# Autodesk Inventor assembly: Ensamblaje1
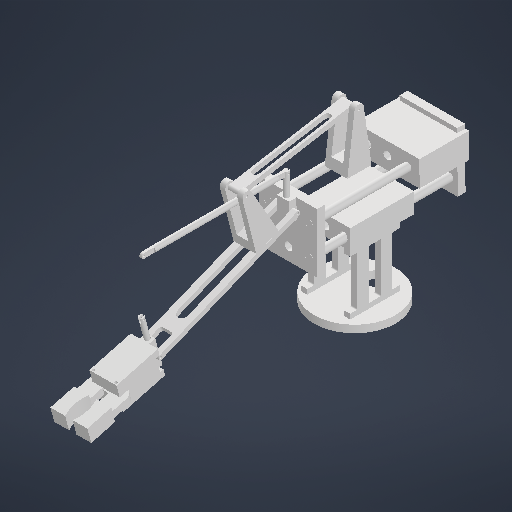
[picture p0: Inventor's stored thumbnail of the model, 512x512]
Saved by Autodesk Inventor 2027.1 (Build 311270010, 270A)
## iProperties
Created: 2026-11-02
Part Number: Ensamblaje1
Document SubType Name: Assembly
Designer: MANGEL
Author: MANGEL
## Documents named in this file (16)
- C:\Users\MANGEL\Desktop\Brazo 4GL\Ensamblaje1.iam
- C:\Users\MANGEL\Desktop\Brazo 4GL\baseCorredera.ipt
- C:\Users\MANGEL\Desktop\Brazo 4GL\BaseRodilloX.ipt
- C:\Users\MANGEL\Desktop\Brazo 4GL\soporteCorrederas.ipt
- C:\Users\MANGEL\Desktop\Brazo 4GL\barraDesliz.ipt
- C:\Users\MANGEL\Desktop\Brazo 4GL\BaseRodilloY.ipt
- C:\Users\MANGEL\Desktop\Brazo 4GL\Pieza14.ipt
- C:\Users\MANGEL\Desktop\Brazo 4GL\soporteBarrasBrazo.ipt
- C:\Users\MANGEL\Desktop\Brazo 4GL\barraBrazo1.ipt
- C:\Users\MANGEL\Desktop\Brazo 4GL\barraBrazo2.ipt
- C:\Users\MANGEL\Desktop\Brazo 4GL\trasePinza.ipt
- C:\Users\MANGEL\Desktop\Brazo 4GL\soportePinza.ipt
- C:\Users\MANGEL\Desktop\Brazo 4GL\pinza.ipt
- C:\Users\MANGEL\Desktop\Brazo 4GL\soporteRodillo.ipt
- C:\Users\MANGEL\Desktop\Brazo 4GL\barillaBrazo.ipt
- C:\Users\MANGEL\Desktop\Brazo 4GL\baseBrazo.ipt
## Components (23 placed, 15 different names)
1. baseCorredera:1 — Nivelación:1, Nivelación:2, Coincidencia:1, Nivelación:5
2. baseCorredera:2 — Nivelación:1, Nivelación:2, Nivelación:3, Nivelación:4
3. BaseRodilloX:1 — Coincidencia:1, Nivelación:3, Nivelación:4, Nivelación:5
4. soporteCorrederas:1 — Insertar:3, Insertar:8, Coincidencia:8
5. soporteCorrederas:2 — Insertar:1, Insertar:4, Insertar:5, Insertar:6, Coincidencia:2, Nivelación:6, Coincidencia:8
6. barraDesliz:1 — Insertar:6, Insertar:8
7. barraDesliz:2 — Insertar:5
8. barraDesliz:3 — Insertar:1, Insertar:3
9. barraDesliz:4 — Insertar:4
10. BaseRodilloY:1 — Coincidencia:3
11. Pieza14:1 — Coincidencia:2, Nivelación:6, Insertar:9
12. soporteBarrasBrazo:1 — Coincidencia:3
13. barraBrazo1:1 — Insertar:9, Coincidencia:4, Nivelación:8, Coincidencia:5, Insertar:11
14. soporteBarrasBrazo:2 — Coincidencia:4, Nivelación:8, Coincidencia:5, Insertar:10
15. barraBrazo2:1 — Insertar:10
16. trasePinza:1 — Insertar:11
17. soportePinza:1
18. pinza:1
19. pinza:2
20. soporteRodillo:1
21. soporteRodillo:2
22. barillaBrazo:1
23. baseBrazo:1
## Relationships (22: Insert 9, Flush 7, Mate 6)
- Nivelación:1 [Flush]: baseCorredera:1 ↔ baseCorredera:2
- Nivelación:2 [Flush]: baseCorredera:1 ↔ baseCorredera:2
- Coincidencia:1 [Mate]: baseCorredera:1 ↔ BaseRodilloX:1
- Nivelación:3 [Flush]: baseCorredera:2 ↔ BaseRodilloX:1
- Nivelación:4 [Flush]: baseCorredera:2 ↔ BaseRodilloX:1
- Nivelación:5 [Flush]: baseCorredera:1 ↔ BaseRodilloX:1
- Insertar:1: soporteCorrederas:2 ↔ barraDesliz:3
- Insertar:3: soporteCorrederas:1 ↔ barraDesliz:3
- Insertar:4: soporteCorrederas:2 ↔ barraDesliz:4
- Insertar:5: soporteCorrederas:2 ↔ barraDesliz:2
- Insertar:6: soporteCorrederas:2 ↔ barraDesliz:1
- Insertar:8: soporteCorrederas:1 ↔ barraDesliz:1
- Coincidencia:2 [Mate]: soporteCorrederas:2 ↔ Pieza14:1
- Nivelación:6 [Flush]: soporteCorrederas:2 ↔ Pieza14:1
- Coincidencia:3 [Mate]: BaseRodilloY:1 ↔ soporteBarrasBrazo:1
- Insertar:9: Pieza14:1 ↔ barraBrazo1:1
- Coincidencia:4 [Mate]: barraBrazo1:1 ↔ soporteBarrasBrazo:2
- Nivelación:8 [Flush]: barraBrazo1:1 ↔ soporteBarrasBrazo:2
- Coincidencia:5 [Mate]: barraBrazo1:1 ↔ soporteBarrasBrazo:2
- Insertar:10: soporteBarrasBrazo:2 ↔ barraBrazo2:1
- Insertar:11: barraBrazo1:1 ↔ trasePinza:1
- Coincidencia:8 [Mate] (320 mm): soporteCorrederas:1 ↔ soporteCorrederas:2
